# Autodesk Inventor assembly: amewi_6208mg.STEP
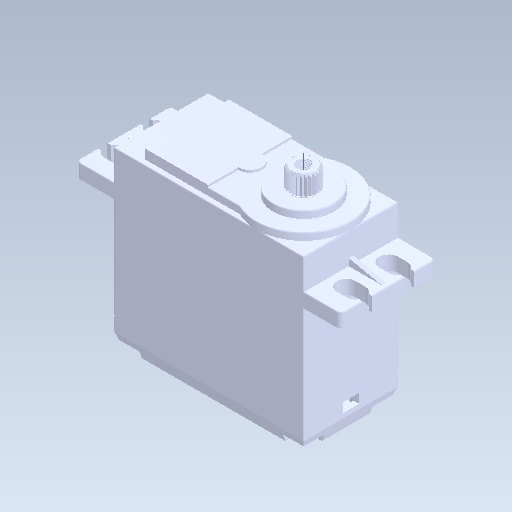
[picture p0: Inventor's stored thumbnail of the model, 512x512]
Saved by Autodesk Inventor 2021 (Build 250183000, 183)
## iProperties
Created: 2026-03-30
Part Number: amewi_6208mg.STEP
Document SubType Name: Assembly
Designer: Admin
Author: Admin
## iProperties of the stored document amewi_teto.ipt
Created: 2026-03-30
Part Number: amewi_teto
Material: Generic
Document SubType Name: Modeling
Designer: Admin
Density: 1 g/cm^3
Appearance: Default
Author: Admin
Revision Number: ANY
## iProperties of the stored document amewi_kozep.ipt
Created: 2026-03-30
Part Number: amewi_kozep
Material: Generic
Document SubType Name: Modeling
Designer: Admin
Density: 1 g/cm^3
Appearance: Default
Author: Admin
Revision Number: ANY
## iProperties of the stored document amewi_6208mg.ipt
Created: 2026-03-30
Part Number: amewi_6208mg
Material: Generic
Document SubType Name: Modeling
Designer: Admin
Density: 1 g/cm^3
Appearance: Default
Author: Admin
Revision Number: ANY
## iProperties of the stored document amewi_tet.ipt
Created: 2026-03-30
Part Number: amewi_tet
Material: Generic
Document SubType Name: Modeling
Designer: Admin
Density: 1 g/cm^3
Appearance: Default
Author: Admin
Revision Number: ANY
## iProperties of the stored document amewi_6208mg.iam
Created: 2021-08-17
Part Number: amewi_6208mg
Description: STEP AP214
Document SubType Name: Assembly
Designer: Admin
Sending System: SolidWorks 2018
Preprocessor: SwSTEP 2.0
Title: amewi_6208mg.STEP
Revision Number: ANY
## iProperties of the stored document servo_end.ipt
Created: 2026-03-30
Part Number: servo_end
Material: Generic
Document SubType Name: Modeling
Designer: Admin
Density: 1 g/cm^3
Appearance: Default
Author: Admin
Revision Number: ANY
## Documents named in this file (9)
- C:\Users\Admin\Desktop\Università\MAGISTRALE\Y2_S2\SOFT ROBOTIC\Project\Model\V4\amewi_6208mg.STEP.iam
- **C:\Users\Admin\Desktop\Università\MAGISTRALE\Y2_S2\SOFT ROBOTIC\Project\Model\V4\amewi_6208mg.STEP.iam*LocalDocs*xAaaaqpbaAaaaaaaaAaaaqz2nYb*amewi_6208mg.iam
- **C:\Users\Admin\Desktop\Università\MAGISTRALE\Y2_S2\SOFT ROBOTIC\Project\Model\V2\amewi_6208mg.STEP.iam*LocalDocs*xAaaaasbaAaaaaaaaAaaaafslUe*amewi_teto.ipt
- **C:\Users\Admin\Desktop\Università\MAGISTRALE\Y2_S2\SOFT ROBOTIC\Project\Model\V2\amewi_6208mg.STEP.iam*LocalDocs*xAaaaadcaAaaaaaaaAaaaatgd1h*amewi_kozep.ipt
- **C:\Users\Admin\Desktop\Università\MAGISTRALE\Y2_S2\SOFT ROBOTIC\Project\Model\V2\amewi_6208mg.STEP.iam*LocalDocs*xAaaaqlaaAaaaaaaaAaaaqtzsYd*amewi_6208mg.ipt
- **C:\Users\Admin\Desktop\Università\MAGISTRALE\Y2_S2\SOFT ROBOTIC\Project\Model\V2\amewi_6208mg.STEP.iam*LocalDocs*xAaaaazaaAaaaaaaaAaaaqxpvNa*amewi_tet.ipt
- **C:\Users\Admin\Desktop\Università\MAGISTRALE\Y2_S2\SOFT ROBOTIC\Project\Model\V2\amewi_6208mg.STEP.iam*LocalDocs*xAaaaqpbaAaaaaaaaAaaaqz2nYb*amewi_6208mg.iam
- **C:\Users\Admin\Desktop\Università\MAGISTRALE\Y2_S2\SOFT ROBOTIC\Project\Model\V2\amewi_6208mg.STEP.iam*LocalDocs*xAaaaqtcaAaaaaaaaAaaaqgup3h*servo_end.ipt
- C:\Users\Admin\Desktop\Università\MAGISTRALE\Y2_S2\SOFT ROBOTIC\Project\Model\V2\amewi_6208mg.STEP
## Components (1 placed, 1 different names)
1. amewi_6208mg:1 [sub-assembly] — Mate:1
## Relationships (1: Mate 1)
- Mate:1: amewi_6208mg:1
